# Autodesk Inventor assembly: ASSEMBLY_DUT_Ant_Rotator_REVC
(part 2 of 3)
304. DIN 912 - replaced by DIN EN ISO 4762 M4 x 10:2
305. DIN 125-1 A A 4,3:9
306. ISO 7380-1 M3 x 12:7
307. ISO 7380-1 M3 x 12:8
308. COTS_Fleximo_FB1ZP20C_20x20_End_Cap:5
309. COTS_Fleximo_FB1NM3_M3_Nut_20x20:5
310. COTS_Fleximo_FB1NM3_M3_Nut_20x20:6
311. COTS_Fleximo_FB1NM3_M3_Nut_20x20:7
312. COTS_Fleximo_FB1NM3_M3_Nut_20x20:8
313. COTS_Fleximo_FB1NM4_M4_Nut_20x20:4
314. COTS_Fleximo_FB1NM4_M4_Nut_20x20:5
315. COTS_Fleximo_FB1NM4_M4_Nut_20x20:6
316. COTS_Fleximo_FB1ZP20C_20x20_End_Cap:8
317. COTS_Fleximo_FB12020_20x20_Alu_Profile_575mm:3
318. 3DP_PLA_Foldable_Leg_Brace_Mount_REVB:5
319. COTS_GENERIC_5mm_Carbon_Rod:3
320. COTS_Fleximo_FB12020_20x20_Alu_Profile_600mm:3 — Flush:51, Flush:53
321. COTS_Fleximo_FBP2020_20x20_Hinge:3
322. COTS_Fleximo_FB1K2020_Angle:5
323. COTS_Fleximo_FB12020_20x20_Alu_Profile_150mm:5 — Mate:880, Flush:50
324. DIN 125-1 A A 4,3:10
325. DIN 912 - replaced by DIN EN ISO 4762 M4 x 16:5
326. DIN 912 - replaced by DIN EN ISO 4762 M4 x 16:6
327. DIN 125-1 A A 4,3:11
328. COTS_Fleximo_FB1K2020_Angle:6
329. 3DP_PLA_Foldable_Leg_Brace_Mount_REVB:6
330. ISO 7380-1 M3 x 12:9
331. ISO 7380-1 M3 x 12:10
332. COTS_Fleximo_FB12020_20x20_Alu_Profile_150mm:6 — Mate:881, Flush:52
333. DIN 912 - replaced by DIN EN ISO 4762 M4 x 10:3
334. DIN 125-1 A A 4,3:12
335. ISO 7380-1 M3 x 12:11
336. ISO 7380-1 M3 x 12:12
337. COTS_Fleximo_FB1ZP20C_20x20_End_Cap:7
338. COTS_Fleximo_FB1NM3_M3_Nut_20x20:9
339. COTS_Fleximo_FB1NM3_M3_Nut_20x20:10
340. COTS_Fleximo_FB1NM3_M3_Nut_20x20:11
341. COTS_Fleximo_FB1NM3_M3_Nut_20x20:12
342. COTS_Fleximo_FB1NM4_M4_Nut_20x20:7
343. COTS_Fleximo_FB1NM4_M4_Nut_20x20:8
344. COTS_Fleximo_FB1NM4_M4_Nut_20x20:9
345. COTS_Fleximo_FB1ZP20C_20x20_End_Cap:9
346. 3DP_PLA_Alu_Frame_Brace_REVB:1 — Mate:855, Flush:46, Mate:856, Mate:860, Mate:865, Mate:866, Mate:867, Mate:868, Mate:874, Mate:876
347. 3DP_PLA_Alu_Frame_Brace_REVB:2 — Mate:857, Flush:47, Mate:858, Mate:859, Angle:74, Mate:861, Mate:862, Mate:863, Mate:864
348. LC_3mm_ALU_Alu_Frame_Brace_REVB:1 — Mate:859, Mate:860, Angle:74, Mate:869, Mate:870, Mate:871, Mate:872, Mate:873, Mate:875
349. DIN 125-1 A A 4,3:21 — Mate:861, Mate:862, Insert:44
350. DIN 912 - replaced by DIN EN ISO 4762 M4 x 10:8 — Insert:44
351. DIN 125-1 A A 4,3:22 — Mate:863, Mate:864, Insert:45
352. DIN 912 - replaced by DIN EN ISO 4762 M4 x 10:9 — Insert:45
353. DIN 125-1 A A 4,3:23 — Mate:865, Mate:866, Insert:46
354. DIN 912 - replaced by DIN EN ISO 4762 M4 x 10:10 — Insert:46
355. DIN 125-1 A A 4,3:24 — Mate:867, Mate:868, Insert:47
356. DIN 912 - replaced by DIN EN ISO 4762 M4 x 10:11 — Insert:47
357. DIN 125-1 A A 4,3:25 — Mate:869, Mate:870, Insert:48
358. DIN 912 - replaced by DIN EN ISO 4762 M4 x 25:1 — Insert:48
359. DIN 934 - replaced by DIN EN 24032/28673/28674 M4:33 — Mate:873, Mate:874
360. DIN 125-1 A A 4,3:26 — Mate:871, Mate:872, Insert:49
361. DIN 912 - replaced by DIN EN ISO 4762 M4 x 25:2 — Insert:49
362. DIN 934 - replaced by DIN EN 24032/28673/28674 M4:34 — Mate:875, Mate:876
363. 3DP_PLA_Alu_Frame_Brace_REVB:3
364. 3DP_PLA_Alu_Frame_Brace_REVB:4
365. LC_3mm_ALU_Alu_Frame_Brace_REVB:2
366. DIN 125-1 A A 4,3:27
367. DIN 912 - replaced by DIN EN ISO 4762 M4 x 10:12
368. DIN 125-1 A A 4,3:28
369. DIN 912 - replaced by DIN EN ISO 4762 M4 x 10:13
370. DIN 125-1 A A 4,3:29
371. DIN 912 - replaced by DIN EN ISO 4762 M4 x 10:14
372. DIN 125-1 A A 4,3:30
373. DIN 912 - replaced by DIN EN ISO 4762 M4 x 10:15
374. DIN 125-1 A A 4,3:31
375. DIN 912 - replaced by DIN EN ISO 4762 M4 x 25:3
376. DIN 934 - replaced by DIN EN 24032/28673/28674 M4:35
377. DIN 125-1 A A 4,3:32
378. DIN 912 - replaced by DIN EN ISO 4762 M4 x 25:4
379. DIN 934 - replaced by DIN EN 24032/28673/28674 M4:36
380. 3DP_PLA_Alu_Frame_Brace_REVB:5
381. 3DP_PLA_Alu_Frame_Brace_REVB:6
382. LC_3mm_ALU_Alu_Frame_Brace_REVB:3
383. DIN 125-1 A A 4,3:33
384. DIN 912 - replaced by DIN EN ISO 4762 M4 x 10:16
385. DIN 125-1 A A 4,3:34
386. DIN 912 - replaced by DIN EN ISO 4762 M4 x 10:17
387. DIN 125-1 A A 4,3:35
388. DIN 912 - replaced by DIN EN ISO 4762 M4 x 10:18
389. DIN 125-1 A A 4,3:36
390. DIN 912 - replaced by DIN EN ISO 4762 M4 x 10:19
391. DIN 125-1 A A 4,3:37
392. DIN 912 - replaced by DIN EN ISO 4762 M4 x 25:5
393. DIN 934 - replaced by DIN EN 24032/28673/28674 M4:37
394. DIN 125-1 A A 4,3:38
395. DIN 912 - replaced by DIN EN ISO 4762 M4 x 25:6
396. DIN 934 - replaced by DIN EN 24032/28673/28674 M4:38
397. 3DP_PLA_Folded_Leg_Holder_REVB:1 — Mate:877, Flush:48, Flush:49, Mate:878, Mate:879
398. DIN 912 - replaced by DIN EN ISO 4762 M4 x 16:7 — Mate:878, Mate:879
399. 3DP_PLA_Folded_Leg_Holder_REVB:2
400. DIN 912 - replaced by DIN EN ISO 4762 M4 x 16:8
401. 3DP_PLA_Folded_Leg_Holder_REVB:3 — Flush:60
402. DIN 912 - replaced by DIN EN ISO 4762 M4 x 16:9
403. ISO 7380-1 M6 x 16:1 — Mate:891, Mate:892
404. 3DP_PLA_Frame_Stiffener_and_Leg_REVB:1 — Mate:890, Flush:54, Flush:55, Mate:891, Mate:892, Mate:893, Mate:894, Mate:895, Mate:896
405. ISO 7380-1 M5 x 8:1 — Mate:893, Mate:894
406. ISO 7380-1 M5 x 8:2 — Mate:895, Mate:896
407. 3DP_PLA_Frame_Stiffener_and_Leg_REVB:2 — Mate:897, Flush:56, Flush:57, Mate:898, Mate:899, Mate:900, Mate:901, Mate:902, Mate:903
408. ISO 7380-1 M6 x 16:2 — Mate:898, Mate:899
409. ISO 7380-1 M5 x 8:3 — Mate:900, Mate:901
410. ISO 7380-1 M5 x 8:4 — Mate:902, Mate:903
411. ISO 7380-1 M6 x 16:3
412. 3DP_PLA_Frame_Stiffener_and_Leg_REVB:3
413. ISO 7380-1 M5 x 8:5
414. ISO 7380-1 M5 x 8:6
415. 3DP_PLA_Frame_Stiffener_and_Leg_REVB:4
416. ISO 7380-1 M6 x 16:4
417. ISO 7380-1 M5 x 8:7
418. ISO 7380-1 M5 x 8:8
419. ISO 7380-1 M6 x 16:5
420. 3DP_PLA_Frame_Stiffener_and_Leg_REVB:5
421. ISO 7380-1 M5 x 8:9
422. ISO 7380-1 M5 x 8:10
423. 3DP_PLA_Frame_Stiffener_and_Leg_REVB:6
424. ISO 7380-1 M6 x 16:6
425. ISO 7380-1 M5 x 8:11
426. ISO 7380-1 M5 x 8:12
427. ISO 7380-1 M5 x 8:13 — Mate:905, Mate:906
428. 3DP_PLA_Frame_Leg_Leg_REVB:1 — Mate:904, Flush:58, Flush:59, Mate:905, Mate:906, Mate:907, Mate:908
429. ISO 7380-1 M5 x 8:14 — Mate:907, Mate:908
430. ISO 7380-1 M5 x 8:15
431. 3DP_PLA_Frame_Leg_Leg_REVB:2
432. ISO 7380-1 M5 x 8:16
433. ISO 7380-1 M5 x 8:17
434. 3DP_PLA_Frame_Leg_Leg_REVB:3
435. ISO 7380-1 M5 x 8:18
## Component patterns: (3 elements, first: COTS_Fleximo_FB12020_20x20_Alu_Profile_575mm:1 + 3DP_PLA_Foldable_Leg_Brace_Mount_REVB:1 + COTS_GENERIC_5mm_Carbon_Rod:1 + COTS_Fleximo_FB12020_20x20_Alu_Profile_600mm:1 + COTS_Fleximo_FBP2020_20x20_Hinge:1 + COTS_Fleximo_FB1K2020_Angle:1 + COTS_Fleximo_FB12020_20x20_Alu_Profile_150mm:2 + DIN 125-1 A A 4,3:5 + DIN 912 - replaced by DIN EN ISO 4762 M4 x 16:1 + DIN 912 - replaced by DIN EN ISO 4762 M4 x 16:2 + DIN 125-1 A A 4,3:6 + COTS_Fleximo_FB1K2020_Angle:2 + 3DP_PLA_Foldable_Leg_Brace_Mount_REVB:2 + ISO 7380-1 M3 x 12:4 + ISO 7380-1 M3 x 12:3 + COTS_Fleximo_FB12020_20x20_Alu_Profile_150mm:1 + DIN 912 - replaced by DIN EN ISO 4762 M4 x 10:1 + DIN 125-1 A A 4,3:4 + ISO 7380-1 M3 x 12:1 + ISO 7380-1 M3 x 12:2 + COTS_Fleximo_FB1ZP20C_20x20_End_Cap:3 + COTS_Fleximo_FB1NM3_M3_Nut_20x20:4 + COTS_Fleximo_FB1NM3_M3_Nut_20x20:3 + COTS_Fleximo_FB1NM3_M3_Nut_20x20:2 + COTS_Fleximo_FB1NM3_M3_Nut_20x20:1 + COTS_Fleximo_FB1NM4_M4_Nut_20x20:1 + COTS_Fleximo_FB1NM4_M4_Nut_20x20:3 + COTS_Fleximo_FB1NM4_M4_Nut_20x20:2 + COTS_Fleximo_FB1ZP20C_20x20_End_Cap:2), (3 elements, first: 3DP_PLA_Alu_Frame_Brace_REVB:1 + 3DP_PLA_Alu_Frame_Brace_REVB:2 + LC_3mm_ALU_Alu_Frame_Brace_REVB:1 + DIN 125-1 A A 4,3:21 + DIN 912 - replaced by DIN EN ISO 4762 M4 x 10:8 + DIN 125-1 A A 4,3:22 + DIN 912 - replaced by DIN EN ISO 4762 M4 x 10:9 + DIN 125-1 A A 4,3:23 + DIN 912 - replaced by DIN EN ISO 4762 M4 x 10:10 + DIN 125-1 A A 4,3:24 + DIN 912 - replaced by DIN EN ISO 4762 M4 x 10:11 + DIN 125-1 A A 4,3:25 + DIN 912 - replaced by DIN EN ISO 4762 M4 x 25:1 + DIN 934 - replaced by DIN EN 24032/28673/28674 M4:33 + DIN 125-1 A A 4,3:26 + DIN 912 - replaced by DIN EN ISO 4762 M4 x 25:2 + DIN 934 - replaced by DIN EN 24032/28673/28674 M4:34), (3 elements, first: 3DP_PLA_Folded_Leg_Holder_REVB:1 + DIN 912 - replaced by DIN EN ISO 4762 M4 x 16:7), (3 elements, first: ISO 7380-1 M6 x 16:1 + 3DP_PLA_Frame_Stiffener_and_Leg_REVB:1 + ISO 7380-1 M5 x 8:1 + ISO 7380-1 M5 x 8:2 + 3DP_PLA_Frame_Stiffener_and_Leg_REVB:2 + ISO 7380-1 M6 x 16:2 + ISO 7380-1 M5 x 8:3 + ISO 7380-1 M5 x 8:4), (3 elements, first: ISO 7380-1 M5 x 8:13 + 3DP_PLA_Frame_Leg_Leg_REVB:1 + ISO 7380-1 M5 x 8:14)
## Relationships (687: Mate 547, Angle 50, Flush 49, Insert 41)
- Mate:1: 3DP_PLA_A_Axis_Bearing_Base:1
- Mate:2: 3DP_PLA_A_Axis_Bearing_Base:1
- Mate:3: COTS_GENERIC_6020_2RS_150x100x24mm_Ball_Bearing:1 ↔ 3DP_PLA_A_Axis_Bearing_Base:1
- Mate:4: COTS_GENERIC_6020_2RS_150x100x24mm_Ball_Bearing:1 ↔ 3DP_PLA_A_Axis_Bearing_Base:1
- Mate:5 (0.2 mm): 3DP_PLA_A_Axis_Bearing_Base:1 ↔ 3DP_PLA_A_Axis_Bearing_Base_Bearing_Locking_Ring:1
- Mate:6: 3DP_PLA_A_Axis_Bearing_Base:1 ↔ 3DP_PLA_A_Axis_Bearing_Base_Bearing_Locking_Ring:1
- Mate:7: 3DP_PLA_A_Axis_Bearing_Base:1 ↔ 3DP_PLA_A_Axis_Bearing_Base_Bearing_Locking_Ring:1
- Mate:8: 3DP_PLA_A_Axis_Bearing_Base_Bearing_Locking_Ring:1 ↔ ISO 7380-1 M4 x 40:1
- Mate:9: 3DP_PLA_A_Axis_Bearing_Base_Bearing_Locking_Ring:1 ↔ ISO 7380-1 M4 x 40:1
- Mate:10: 3DP_PLA_A_Axis_Bearing_Base_Bearing_Locking_Ring:1 ↔ ISO 7380-1 M4 x 40:2
- Mate:11: 3DP_PLA_A_Axis_Bearing_Base_Bearing_Locking_Ring:1 ↔ ISO 7380-1 M4 x 40:2
- Mate:12: 3DP_PLA_A_Axis_Bearing_Base_Bearing_Locking_Ring:1 ↔ ISO 7380-1 M4 x 40:3
- Mate:13: 3DP_PLA_A_Axis_Bearing_Base_Bearing_Locking_Ring:1 ↔ ISO 7380-1 M4 x 40:3
- Mate:14: 3DP_PLA_A_Axis_Bearing_Base_Bearing_Locking_Ring:1 ↔ ISO 7380-1 M4 x 40:4
- Mate:15: 3DP_PLA_A_Axis_Bearing_Base_Bearing_Locking_Ring:1 ↔ ISO 7380-1 M4 x 40:4
- Mate:16: 3DP_PLA_A_Axis_Bearing_Base_Bearing_Locking_Ring:1 ↔ ISO 7380-1 M4 x 40:5
- Mate:17: 3DP_PLA_A_Axis_Bearing_Base_Bearing_Locking_Ring:1 ↔ ISO 7380-1 M4 x 40:5
- Mate:18: 3DP_PLA_A_Axis_Bearing_Base_Bearing_Locking_Ring:1 ↔ ISO 7380-1 M4 x 40:6
- Mate:19: 3DP_PLA_A_Axis_Bearing_Base_Bearing_Locking_Ring:1 ↔ ISO 7380-1 M4 x 40:6
- Mate:20: 3DP_PLA_A_Axis_Bearing_Base_Bearing_Locking_Ring:1 ↔ ISO 7380-1 M4 x 40:7
- Mate:21: 3DP_PLA_A_Axis_Bearing_Base_Bearing_Locking_Ring:1 ↔ ISO 7380-1 M4 x 40:7
- Mate:22: 3DP_PLA_A_Axis_Bearing_Base_Bearing_Locking_Ring:1 ↔ ISO 7380-1 M4 x 40:8
- Mate:23: 3DP_PLA_A_Axis_Bearing_Base_Bearing_Locking_Ring:1 ↔ ISO 7380-1 M4 x 40:8
- Mate:24: 3DP_PLA_A_Axis_Bearing_Base_Bearing_Locking_Ring:1 ↔ DIN 934 - replaced by DIN EN 24032/28673/28674 M4:1
- Mate:25: 3DP_PLA_A_Axis_Bearing_Base:1 ↔ DIN 934 - replaced by DIN EN 24032/28673/28674 M4:1
- Mate:26: 3DP_PLA_A_Axis_Bearing_Base_Bearing_Locking_Ring:1 ↔ DIN 934 - replaced by DIN EN 24032/28673/28674 M4:2
- Mate:27: 3DP_PLA_A_Axis_Bearing_Base:1 ↔ DIN 934 - replaced by DIN EN 24032/28673/28674 M4:2
- Mate:28: 3DP_PLA_A_Axis_Bearing_Base_Bearing_Locking_Ring:1 ↔ DIN 934 - replaced by DIN EN 24032/28673/28674 M4:3
- Mate:29: 3DP_PLA_A_Axis_Bearing_Base:1 ↔ DIN 934 - replaced by DIN EN 24032/28673/28674 M4:3
- Mate:30: 3DP_PLA_A_Axis_Bearing_Base_Bearing_Locking_Ring:1 ↔ DIN 934 - replaced by DIN EN 24032/28673/28674 M4:4
- Mate:31: 3DP_PLA_A_Axis_Bearing_Base:1 ↔ DIN 934 - replaced by DIN EN 24032/28673/28674 M4:4
- Mate:32: 3DP_PLA_A_Axis_Bearing_Base_Bearing_Locking_Ring:1 ↔ DIN 934 - replaced by DIN EN 24032/28673/28674 M4:5
- Mate:33: 3DP_PLA_A_Axis_Bearing_Base:1 ↔ DIN 934 - replaced by DIN EN 24032/28673/28674 M4:5
- Mate:34: 3DP_PLA_A_Axis_Bearing_Base_Bearing_Locking_Ring:1 ↔ DIN 934 - replaced by DIN EN 24032/28673/28674 M4:6
- Mate:35: 3DP_PLA_A_Axis_Bearing_Base:1 ↔ DIN 934 - replaced by DIN EN 24032/28673/28674 M4:6
- Mate:36: 3DP_PLA_A_Axis_Bearing_Base_Bearing_Locking_Ring:1 ↔ DIN 934 - replaced by DIN EN 24032/28673/28674 M4:7
- Mate:37: 3DP_PLA_A_Axis_Bearing_Base:1 ↔ DIN 934 - replaced by DIN EN 24032/28673/28674 M4:7
- Mate:38: 3DP_PLA_A_Axis_Bearing_Base_Bearing_Locking_Ring:1 ↔ DIN 934 - replaced by DIN EN 24032/28673/28674 M4:8
- Mate:39: 3DP_PLA_A_Axis_Bearing_Base:1 ↔ DIN 934 - replaced by DIN EN 24032/28673/28674 M4:8
- Angle:1 (0 deg): 3DP_PLA_A_Axis_Bearing_Base:1 ↔ DIN 934 - replaced by DIN EN 24032/28673/28674 M4:2
- Angle:2 (0 deg): 3DP_PLA_A_Axis_Bearing_Base:1 ↔ DIN 934 - replaced by DIN EN 24032/28673/28674 M4:3
- Angle:3 (0 deg): 3DP_PLA_A_Axis_Bearing_Base:1 ↔ DIN 934 - replaced by DIN EN 24032/28673/28674 M4:4
- Angle:4 (0 deg): 3DP_PLA_A_Axis_Bearing_Base:1 ↔ DIN 934 - replaced by DIN EN 24032/28673/28674 M4:5
- Angle:5 (0 deg): 3DP_PLA_A_Axis_Bearing_Base:1 ↔ DIN 934 - replaced by DIN EN 24032/28673/28674 M4:6
- Angle:6 (0 deg): 3DP_PLA_A_Axis_Bearing_Base:1 ↔ DIN 934 - replaced by DIN EN 24032/28673/28674 M4:7
- Angle:7 (0 deg): 3DP_PLA_A_Axis_Bearing_Base:1 ↔ DIN 934 - replaced by DIN EN 24032/28673/28674 M4:8
- Angle:8 (0 deg): 3DP_PLA_A_Axis_Bearing_Base:1 ↔ DIN 934 - replaced by DIN EN 24032/28673/28674 M4:1
- Mate:40: COTS_GENERIC_6020_2RS_150x100x24mm_Ball_Bearing:1 ↔ 3DP_PLA_A_Axis_Rotating_Stage:1
- Mate:41: COTS_GENERIC_6020_2RS_150x100x24mm_Ball_Bearing:1 ↔ 3DP_PLA_A_Axis_Rotating_Stage:1
- Mate:42: COTS_GENERIC_6020_2RS_150x100x24mm_Ball_Bearing:1 ↔ 3DP_PLA_A_Axis_Rotating_Stage_Mounting_Plate:1
- Mate:43: COTS_GENERIC_6020_2RS_150x100x24mm_Ball_Bearing:1 ↔ 3DP_PLA_A_Axis_Rotating_Stage_Mounting_Plate:1
- Mate:44: 3DP_PLA_A_Axis_Rotating_Stage:1 ↔ 3DP_PLA_A_Axis_Rotating_Stage_Mounting_Plate:1
- Mate:45: 3DP_PLA_A_Axis_Rotating_Stage:1 ↔ DIN 912 - replaced by DIN EN ISO 4762 M5 x 50:1
- Mate:46: 3DP_PLA_A_Axis_Rotating_Stage:1 ↔ DIN 912 - replaced by DIN EN ISO 4762 M5 x 50:1
- Mate:47: 3DP_PLA_A_Axis_Rotating_Stage:1 ↔ DIN 912 - replaced by DIN EN ISO 4762 M5 x 50:2
- Mate:48: 3DP_PLA_A_Axis_Rotating_Stage:1 ↔ DIN 912 - replaced by DIN EN ISO 4762 M5 x 50:2
- Mate:49: 3DP_PLA_A_Axis_Rotating_Stage:1 ↔ DIN 912 - replaced by DIN EN ISO 4762 M5 x 50:3
- Mate:50: 3DP_PLA_A_Axis_Rotating_Stage:1 ↔ DIN 912 - replaced by DIN EN ISO 4762 M5 x 50:3
- Mate:51: 3DP_PLA_A_Axis_Rotating_Stage:1 ↔ DIN 912 - replaced by DIN EN ISO 4762 M5 x 50:4
- Mate:52: 3DP_PLA_A_Axis_Rotating_Stage:1 ↔ DIN 912 - replaced by DIN EN ISO 4762 M5 x 50:4
- Mate:53: 3DP_PLA_A_Axis_Rotating_Stage:1 ↔ DIN 912 - replaced by DIN EN ISO 4762 M5 x 50:5
- Mate:54: 3DP_PLA_A_Axis_Rotating_Stage:1 ↔ DIN 912 - replaced by DIN EN ISO 4762 M5 x 50:5
- Mate:55: 3DP_PLA_A_Axis_Rotating_Stage:1 ↔ DIN 912 - replaced by DIN EN ISO 4762 M5 x 50:6
- Mate:56: 3DP_PLA_A_Axis_Rotating_Stage:1 ↔ DIN 912 - replaced by DIN EN ISO 4762 M5 x 50:6
- Mate:57: 3DP_PLA_A_Axis_Rotating_Stage:1 ↔ DIN 912 - replaced by DIN EN ISO 4762 M5 x 50:7
- Mate:58: 3DP_PLA_A_Axis_Rotating_Stage:1 ↔ DIN 912 - replaced by DIN EN ISO 4762 M5 x 50:7
- Mate:59: 3DP_PLA_A_Axis_Rotating_Stage:1 ↔ DIN 912 - replaced by DIN EN ISO 4762 M5 x 50:8
- Mate:60: 3DP_PLA_A_Axis_Rotating_Stage:1 ↔ DIN 912 - replaced by DIN EN ISO 4762 M5 x 50:8
- Mate:61: 3DP_PLA_A_Axis_Rotating_Stage:1 ↔ DIN 934 - replaced by DIN EN 24032/28673/28674 M5:1
- Mate:62: 3DP_PLA_A_Axis_Rotating_Stage_Mounting_Plate:1 ↔ DIN 934 - replaced by DIN EN 24032/28673/28674 M5:1
- Mate:63: 3DP_PLA_A_Axis_Rotating_Stage:1 ↔ DIN 934 - replaced by DIN EN 24032/28673/28674 M5:2
- Mate:64: 3DP_PLA_A_Axis_Rotating_Stage_Mounting_Plate:1 ↔ DIN 934 - replaced by DIN EN 24032/28673/28674 M5:2
- Mate:65: 3DP_PLA_A_Axis_Rotating_Stage:1 ↔ DIN 934 - replaced by DIN EN 24032/28673/28674 M5:3
- Mate:66: 3DP_PLA_A_Axis_Rotating_Stage_Mounting_Plate:1 ↔ DIN 934 - replaced by DIN EN 24032/28673/28674 M5:3
- Mate:67: 3DP_PLA_A_Axis_Rotating_Stage:1 ↔ DIN 934 - replaced by DIN EN 24032/28673/28674 M5:4
- Mate:68: 3DP_PLA_A_Axis_Rotating_Stage_Mounting_Plate:1 ↔ DIN 934 - replaced by DIN EN 24032/28673/28674 M5:4
- Mate:69: 3DP_PLA_A_Axis_Rotating_Stage:1 ↔ DIN 934 - replaced by DIN EN 24032/28673/28674 M5:5
- Mate:70: 3DP_PLA_A_Axis_Rotating_Stage_Mounting_Plate:1 ↔ DIN 934 - replaced by DIN EN 24032/28673/28674 M5:5
- Mate:71: 3DP_PLA_A_Axis_Rotating_Stage:1 ↔ DIN 934 - replaced by DIN EN 24032/28673/28674 M5:6
- Mate:72: 3DP_PLA_A_Axis_Rotating_Stage_Mounting_Plate:1 ↔ DIN 934 - replaced by DIN EN 24032/28673/28674 M5:6
- Mate:73: 3DP_PLA_A_Axis_Rotating_Stage:1 ↔ DIN 934 - replaced by DIN EN 24032/28673/28674 M5:7
- Mate:74: 3DP_PLA_A_Axis_Rotating_Stage_Mounting_Plate:1 ↔ DIN 934 - replaced by DIN EN 24032/28673/28674 M5:7
- Mate:75: 3DP_PLA_A_Axis_Rotating_Stage:1 ↔ DIN 934 - replaced by DIN EN 24032/28673/28674 M5:8
- Mate:76: 3DP_PLA_A_Axis_Rotating_Stage_Mounting_Plate:1 ↔ DIN 934 - replaced by DIN EN 24032/28673/28674 M5:8
- Angle:9 (0 deg): 3DP_PLA_A_Axis_Rotating_Stage_Mounting_Plate:1 ↔ DIN 934 - replaced by DIN EN 24032/28673/28674 M5:2
- Angle:10 (0 deg): 3DP_PLA_A_Axis_Rotating_Stage_Mounting_Plate:1 ↔ DIN 934 - replaced by DIN EN 24032/28673/28674 M5:3
- Angle:11 (0 deg): 3DP_PLA_A_Axis_Rotating_Stage_Mounting_Plate:1 ↔ DIN 934 - replaced by DIN EN 24032/28673/28674 M5:4
- Angle:12 (0 deg): 3DP_PLA_A_Axis_Rotating_Stage_Mounting_Plate:1 ↔ DIN 934 - replaced by DIN EN 24032/28673/28674 M5:5
- Angle:13 (0 deg): 3DP_PLA_A_Axis_Rotating_Stage_Mounting_Plate:1 ↔ DIN 934 - replaced by DIN EN 24032/28673/28674 M5:6
- Angle:14 (0 deg): 3DP_PLA_A_Axis_Rotating_Stage_Mounting_Plate:1 ↔ DIN 934 - replaced by DIN EN 24032/28673/28674 M5:7
- Angle:15 (0 deg): 3DP_PLA_A_Axis_Rotating_Stage_Mounting_Plate:1 ↔ DIN 934 - replaced by DIN EN 24032/28673/28674 M5:8
- Angle:16 (0 deg): 3DP_PLA_A_Axis_Rotating_Stage_Mounting_Plate:1 ↔ DIN 934 - replaced by DIN EN 24032/28673/28674 M5:1
- Mate:77: COTS_MKS_SERVO42D_40mm:1 ↔ COTS_GENERIC_HTD3M_24T_6mm_5mm_shaft_pulley:1
- Mate:78: 3DP_PLA_A_Axis_Rotating_Stage:1 ↔ COTS_GENERIC_HTD3M_6mm_675mm_Closed_belt_A_Axis:1
- Mate:79 (0.5 mm): 3DP_PLA_A_Axis_Rotating_Stage:1 ↔ COTS_GENERIC_HTD3M_6mm_675mm_Closed_belt_A_Axis:1
- Angle:17 (0 deg): 3DP_PLA_A_Axis_Bearing_Base:1
- Mate:80: 3DP_PLA_A_Axis_Bearing_Base:1 ↔ 3DP_PLA_A_Axis_Stepper_Mount_REVB:1
- Mate:81: 3DP_PLA_A_Axis_Bearing_Base:1 ↔ 3DP_PLA_A_Axis_Stepper_Mount_REVB:1
- Mate:82: 3DP_PLA_A_Axis_Bearing_Base:1 ↔ 3DP_PLA_A_Axis_Stepper_Mount_REVB:1
- Mate:83: 3DP_PLA_A_Axis_Stepper_Mount_REVB:1 ↔ ISO 7380-1 M4 x 40:9
- Mate:84: 3DP_PLA_A_Axis_Stepper_Mount_REVB:1 ↔ ISO 7380-1 M4 x 40:9
- Mate:85: 3DP_PLA_A_Axis_Stepper_Mount_REVB:1 ↔ ISO 7380-1 M4 x 40:10
- Mate:86: 3DP_PLA_A_Axis_Stepper_Mount_REVB:1 ↔ ISO 7380-1 M4 x 40:10
- Mate:87: 3DP_PLA_A_Axis_Stepper_Mount_REVB:1 ↔ ISO 7380-1 M4 x 40:11
- Mate:88: 3DP_PLA_A_Axis_Stepper_Mount_REVB:1 ↔ ISO 7380-1 M4 x 40:11
- Mate:89: 3DP_PLA_A_Axis_Stepper_Mount_REVB:1 ↔ DIN 934 - replaced by DIN EN 24032/28673/28674 M4:9
- Mate:90: 3DP_PLA_A_Axis_Bearing_Base:1 ↔ DIN 934 - replaced by DIN EN 24032/28673/28674 M4:9
- Mate:91: 3DP_PLA_A_Axis_Stepper_Mount_REVB:1 ↔ DIN 934 - replaced by DIN EN 24032/28673/28674 M4:10
- Mate:92: 3DP_PLA_A_Axis_Bearing_Base:1 ↔ DIN 934 - replaced by DIN EN 24032/28673/28674 M4:10
- Mate:93: 3DP_PLA_A_Axis_Stepper_Mount_REVB:1 ↔ DIN 934 - replaced by DIN EN 24032/28673/28674 M4:11
- Mate:94: 3DP_PLA_A_Axis_Bearing_Base:1 ↔ DIN 934 - replaced by DIN EN 24032/28673/28674 M4:11
- Angle:18 (0 deg): 3DP_PLA_A_Axis_Bearing_Base:1 ↔ DIN 934 - replaced by DIN EN 24032/28673/28674 M4:9
- Angle:19 (0 deg): 3DP_PLA_A_Axis_Bearing_Base:1 ↔ DIN 934 - replaced by DIN EN 24032/28673/28674 M4:10
- Angle:20 (0 deg): 3DP_PLA_A_Axis_Bearing_Base:1 ↔ DIN 934 - replaced by DIN EN 24032/28673/28674 M4:11
- Mate:95: 3DP_PLA_A_Axis_Stepper_Mount_REVB:1 ↔ ASSEMBLY_HTD3M_Idler_A_Axis:2
- Mate:96: 3DP_PLA_A_Axis_Stepper_Mount_REVB:1 ↔ ASSEMBLY_HTD3M_Idler_A_Axis:1
- Mate:97: 3DP_PLA_A_Axis_Stepper_Mount_REVB:1 ↔ ASSEMBLY_HTD3M_Idler_A_Axis:2
- Mate:98: 3DP_PLA_A_Axis_Stepper_Mount_REVB:1 ↔ ASSEMBLY_HTD3M_Idler_A_Axis:1
- Mate:107: COTS_MKS_SERVO42D_40mm:1 ↔ 3DP_PLA_A_Axis_Stepper_Mount_REVB:1
- Mate:108 (1.6 mm): COTS_MKS_SERVO42D_40mm:1 ↔ 3DP_PLA_A_Axis_Stepper_Mount_REVB:1
- Mate:109 (1.6 mm): COTS_MKS_SERVO42D_40mm:1 ↔ 3DP_PLA_A_Axis_Stepper_Mount_REVB:1
- Mate:110: COTS_MKS_SERVO42D_40mm:1 ↔ DIN 125-1 A A 3,2:1
- Mate:111: 3DP_PLA_A_Axis_Stepper_Mount_REVB:1 ↔ DIN 125-1 A A 3,2:1
- Mate:112: COTS_MKS_SERVO42D_40mm:1 ↔ DIN 125-1 A A 3,2:2
- Mate:113: 3DP_PLA_A_Axis_Stepper_Mount_REVB:1 ↔ DIN 125-1 A A 3,2:2
- Mate:114: COTS_MKS_SERVO42D_40mm:1 ↔ DIN 125-1 A A 3,2:3
- Mate:115: 3DP_PLA_A_Axis_Stepper_Mount_REVB:1 ↔ DIN 125-1 A A 3,2:3
- Mate:116: COTS_MKS_SERVO42D_40mm:1 ↔ DIN 125-1 A A 3,2:4
- Mate:117: 3DP_PLA_A_Axis_Stepper_Mount_REVB:1 ↔ DIN 125-1 A A 3,2:4
- Insert:1: ISO 7380-1 M3 x 16:1 ↔ DIN 125-1 A A 3,2:1
- Insert:2: ISO 7380-1 M3 x 16:2 ↔ DIN 125-1 A A 3,2:2
- Insert:3: ISO 7380-1 M3 x 16:3 ↔ DIN 125-1 A A 3,2:3
- Insert:4: ISO 7380-1 M3 x 16:4 ↔ DIN 125-1 A A 3,2:4
- Mate:118: COTS_GENERIC_HTD3M_24T_6mm_5mm_shaft_pulley:1 ↔ COTS_GENERIC_HTD3M_6mm_675mm_Closed_belt_A_Axis:1
- Mate:119 (0.5 mm): COTS_GENERIC_HTD3M_24T_6mm_5mm_shaft_pulley:1 ↔ COTS_GENERIC_HTD3M_6mm_675mm_Closed_belt_A_Axis:1
- Mate:121: 3DP_PLA_A_Axis_Rotating_Stage:1 ↔ 3DP_PLA_A_Axis_Rotating_Stage_Fiberglass_pipes_mount_plate:1
- Mate:122: 3DP_PLA_A_Axis_Rotating_Stage:1 ↔ 3DP_PLA_A_Axis_Rotating_Stage_Fiberglass_pipes_mount_plate:1
- Mate:123: 3DP_PLA_A_Axis_Rotating_Stage:1 ↔ 3DP_PLA_A_Axis_Rotating_Stage_Fiberglass_pipes_mount_plate:1
- Mate:127 (1 mm): 3DP_PLA_A_Axis_Rotating_Stage_Fiberglass_pipes_mount_plate:1 ↔ 3DP_PLA_A_Axis_Rotating_Stage_Fiberglass_pipes_mount_clamp:2
- Mate:128 (1 mm): 3DP_PLA_A_Axis_Rotating_Stage_Fiberglass_pipes_mount_plate:1 ↔ 3DP_PLA_A_Axis_Rotating_Stage_Fiberglass_pipes_mount_clamp:1
- Flush:3: 3DP_PLA_A_Axis_Rotating_Stage_Fiberglass_pipes_mount_plate:1 ↔ 3DP_PLA_A_Axis_Rotating_Stage_Fiberglass_pipes_mount_clamp:2
- Flush:4: 3DP_PLA_A_Axis_Rotating_Stage_Fiberglass_pipes_mount_plate:1 ↔ 3DP_PLA_A_Axis_Rotating_Stage_Fiberglass_pipes_mount_clamp:2
- Flush:5: 3DP_PLA_A_Axis_Rotating_Stage_Fiberglass_pipes_mount_plate:1 ↔ 3DP_PLA_A_Axis_Rotating_Stage_Fiberglass_pipes_mount_clamp:1
- Flush:6: 3DP_PLA_A_Axis_Rotating_Stage_Fiberglass_pipes_mount_plate:1 ↔ 3DP_PLA_A_Axis_Rotating_Stage_Fiberglass_pipes_mount_clamp:1
- Mate:129: 3DP_PLA_A_Axis_Rotating_Stage_Fiberglass_pipes_mount_clamp:2 ↔ DIN 912 - replaced by DIN EN ISO 4762 M5 x 50:9
- Mate:130: 3DP_PLA_A_Axis_Rotating_Stage_Fiberglass_pipes_mount_clamp:2 ↔ DIN 912 - replaced by DIN EN ISO 4762 M5 x 50:9
- Mate:131: 3DP_PLA_A_Axis_Rotating_Stage_Fiberglass_pipes_mount_clamp:2 ↔ DIN 912 - replaced by DIN EN ISO 4762 M5 x 50:10
- Mate:132: 3DP_PLA_A_Axis_Rotating_Stage_Fiberglass_pipes_mount_clamp:2 ↔ DIN 912 - replaced by DIN EN ISO 4762 M5 x 50:10
- Mate:133: 3DP_PLA_A_Axis_Rotating_Stage_Fiberglass_pipes_mount_clamp:2 ↔ DIN 912 - replaced by DIN EN ISO 4762 M5 x 50:11
- Mate:134: 3DP_PLA_A_Axis_Rotating_Stage_Fiberglass_pipes_mount_clamp:2 ↔ DIN 912 - replaced by DIN EN ISO 4762 M5 x 50:11
- Mate:135: 3DP_PLA_A_Axis_Rotating_Stage_Fiberglass_pipes_mount_clamp:2 ↔ DIN 912 - replaced by DIN EN ISO 4762 M5 x 50:12
- Mate:136: 3DP_PLA_A_Axis_Rotating_Stage_Fiberglass_pipes_mount_clamp:2 ↔ DIN 912 - replaced by DIN EN ISO 4762 M5 x 50:12
- Mate:137: 3DP_PLA_A_Axis_Rotating_Stage_Fiberglass_pipes_mount_clamp:2 ↔ DIN 912 - replaced by DIN EN ISO 4762 M5 x 50:13
- Mate:138: 3DP_PLA_A_Axis_Rotating_Stage_Fiberglass_pipes_mount_clamp:2 ↔ DIN 912 - replaced by DIN EN ISO 4762 M5 x 50:13
- Mate:139: 3DP_PLA_A_Axis_Rotating_Stage_Fiberglass_pipes_mount_clamp:2 ↔ DIN 912 - replaced by DIN EN ISO 4762 M5 x 50:14
- Mate:140: 3DP_PLA_A_Axis_Rotating_Stage_Fiberglass_pipes_mount_clamp:2 ↔ DIN 912 - replaced by DIN EN ISO 4762 M5 x 50:14
- Mate:141: 3DP_PLA_A_Axis_Rotating_Stage_Fiberglass_pipes_mount_clamp:1 ↔ DIN 912 - replaced by DIN EN ISO 4762 M5 x 50:15
- Mate:142: 3DP_PLA_A_Axis_Rotating_Stage_Fiberglass_pipes_mount_clamp:2 ↔ DIN 912 - replaced by DIN EN ISO 4762 M5 x 50:15
- Mate:143: 3DP_PLA_A_Axis_Rotating_Stage_Fiberglass_pipes_mount_clamp:1 ↔ DIN 912 - replaced by DIN EN ISO 4762 M5 x 50:16
- Mate:144: 3DP_PLA_A_Axis_Rotating_Stage_Fiberglass_pipes_mount_clamp:2 ↔ DIN 912 - replaced by DIN EN ISO 4762 M5 x 50:16
- Mate:145: 3DP_PLA_A_Axis_Rotating_Stage_Fiberglass_pipes_mount_clamp:1 ↔ DIN 912 - replaced by DIN EN ISO 4762 M5 x 50:17
- Mate:146: 3DP_PLA_A_Axis_Rotating_Stage_Fiberglass_pipes_mount_clamp:2 ↔ DIN 912 - replaced by DIN EN ISO 4762 M5 x 50:17
- Mate:147: 3DP_PLA_A_Axis_Rotating_Stage_Fiberglass_pipes_mount_clamp:1 ↔ DIN 912 - replaced by DIN EN ISO 4762 M5 x 50:18
- Mate:148: 3DP_PLA_A_Axis_Rotating_Stage_Fiberglass_pipes_mount_clamp:2 ↔ DIN 912 - replaced by DIN EN ISO 4762 M5 x 50:18
- Mate:149: 3DP_PLA_A_Axis_Rotating_Stage_Fiberglass_pipes_mount_clamp:1 ↔ DIN 912 - replaced by DIN EN ISO 4762 M5 x 50:19
- Mate:150: 3DP_PLA_A_Axis_Rotating_Stage_Fiberglass_pipes_mount_clamp:2 ↔ DIN 912 - replaced by DIN EN ISO 4762 M5 x 50:19
- Mate:151: 3DP_PLA_A_Axis_Rotating_Stage_Fiberglass_pipes_mount_clamp:1 ↔ DIN 912 - replaced by DIN EN ISO 4762 M5 x 50:20
- Mate:152: 3DP_PLA_A_Axis_Rotating_Stage_Fiberglass_pipes_mount_clamp:2 ↔ DIN 912 - replaced by DIN EN ISO 4762 M5 x 50:20
- Mate:153: 3DP_PLA_A_Axis_Rotating_Stage_Fiberglass_pipes_mount_clamp:2 ↔ DIN 934 - replaced by DIN EN 24032/28673/28674 M5:9
- Mate:154: 3DP_PLA_A_Axis_Rotating_Stage_Fiberglass_pipes_mount_plate:1 ↔ DIN 934 - replaced by DIN EN 24032/28673/28674 M5:9
- Mate:155: 3DP_PLA_A_Axis_Rotating_Stage_Fiberglass_pipes_mount_clamp:2 ↔ DIN 934 - replaced by DIN EN 24032/28673/28674 M5:10
- Mate:156: 3DP_PLA_A_Axis_Rotating_Stage_Fiberglass_pipes_mount_plate:1 ↔ DIN 934 - replaced by DIN EN 24032/28673/28674 M5:10
- Mate:157: 3DP_PLA_A_Axis_Rotating_Stage_Fiberglass_pipes_mount_clamp:2 ↔ DIN 934 - replaced by DIN EN 24032/28673/28674 M5:11
- Mate:158: 3DP_PLA_A_Axis_Rotating_Stage_Fiberglass_pipes_mount_plate:1 ↔ DIN 934 - replaced by DIN EN 24032/28673/28674 M5:11
- Mate:159: 3DP_PLA_A_Axis_Rotating_Stage_Fiberglass_pipes_mount_clamp:2 ↔ DIN 934 - replaced by DIN EN 24032/28673/28674 M5:12
- Mate:160: 3DP_PLA_A_Axis_Rotating_Stage_Fiberglass_pipes_mount_plate:1 ↔ DIN 934 - replaced by DIN EN 24032/28673/28674 M5:12
- Mate:161: 3DP_PLA_A_Axis_Rotating_Stage_Fiberglass_pipes_mount_clamp:2 ↔ DIN 934 - replaced by DIN EN 24032/28673/28674 M5:13
- Mate:162: 3DP_PLA_A_Axis_Rotating_Stage_Fiberglass_pipes_mount_plate:1 ↔ DIN 934 - replaced by DIN EN 24032/28673/28674 M5:13
- Mate:163: 3DP_PLA_A_Axis_Rotating_Stage_Fiberglass_pipes_mount_clamp:2 ↔ DIN 934 - replaced by DIN EN 24032/28673/28674 M5:14
- Mate:164: 3DP_PLA_A_Axis_Rotating_Stage_Fiberglass_pipes_mount_plate:1 ↔ DIN 934 - replaced by DIN EN 24032/28673/28674 M5:14
- Mate:165: 3DP_PLA_A_Axis_Rotating_Stage_Fiberglass_pipes_mount_clamp:1 ↔ DIN 934 - replaced by DIN EN 24032/28673/28674 M5:15
- Mate:166: 3DP_PLA_A_Axis_Rotating_Stage_Fiberglass_pipes_mount_plate:1 ↔ DIN 934 - replaced by DIN EN 24032/28673/28674 M5:15
- Mate:167: 3DP_PLA_A_Axis_Rotating_Stage_Fiberglass_pipes_mount_clamp:1 ↔ DIN 934 - replaced by DIN EN 24032/28673/28674 M5:16
- Mate:168: 3DP_PLA_A_Axis_Rotating_Stage_Fiberglass_pipes_mount_plate:1 ↔ DIN 934 - replaced by DIN EN 24032/28673/28674 M5:16
- Mate:169: 3DP_PLA_A_Axis_Rotating_Stage_Fiberglass_pipes_mount_clamp:1 ↔ DIN 934 - replaced by DIN EN 24032/28673/28674 M5:17
- Mate:170: 3DP_PLA_A_Axis_Rotating_Stage_Fiberglass_pipes_mount_plate:1 ↔ DIN 934 - replaced by DIN EN 24032/28673/28674 M5:17
- Mate:171: 3DP_PLA_A_Axis_Rotating_Stage_Fiberglass_pipes_mount_clamp:1 ↔ DIN 934 - replaced by DIN EN 24032/28673/28674 M5:18
- Mate:172: 3DP_PLA_A_Axis_Rotating_Stage_Fiberglass_pipes_mount_plate:1 ↔ DIN 934 - replaced by DIN EN 24032/28673/28674 M5:18
- Mate:173: 3DP_PLA_A_Axis_Rotating_Stage_Fiberglass_pipes_mount_clamp:1 ↔ DIN 934 - replaced by DIN EN 24032/28673/28674 M5:19
- Mate:174: 3DP_PLA_A_Axis_Rotating_Stage_Fiberglass_pipes_mount_plate:1 ↔ DIN 934 - replaced by DIN EN 24032/28673/28674 M5:19
- Mate:175: 3DP_PLA_A_Axis_Rotating_Stage_Fiberglass_pipes_mount_clamp:1 ↔ DIN 934 - replaced by DIN EN 24032/28673/28674 M5:20
- Mate:176: 3DP_PLA_A_Axis_Rotating_Stage_Fiberglass_pipes_mount_plate:1 ↔ DIN 934 - replaced by DIN EN 24032/28673/28674 M5:20
- Angle:21 (0 deg): 3DP_PLA_A_Axis_Rotating_Stage_Fiberglass_pipes_mount_plate:1 ↔ DIN 934 - replaced by DIN EN 24032/28673/28674 M5:9
- Angle:22 (0 deg): 3DP_PLA_A_Axis_Rotating_Stage_Fiberglass_pipes_mount_plate:1 ↔ DIN 934 - replaced by DIN EN 24032/28673/28674 M5:12
- Angle:23 (0 deg): 3DP_PLA_A_Axis_Rotating_Stage_Fiberglass_pipes_mount_plate:1 ↔ DIN 934 - replaced by DIN EN 24032/28673/28674 M5:13
- Angle:24 (0 deg): 3DP_PLA_A_Axis_Rotating_Stage_Fiberglass_pipes_mount_plate:1 ↔ DIN 934 - replaced by DIN EN 24032/28673/28674 M5:14
- Angle:25 (0 deg): 3DP_PLA_A_Axis_Rotating_Stage_Fiberglass_pipes_mount_plate:1 ↔ DIN 934 - replaced by DIN EN 24032/28673/28674 M5:11
- Angle:26 (0 deg): 3DP_PLA_A_Axis_Rotating_Stage_Fiberglass_pipes_mount_plate:1 ↔ DIN 934 - replaced by DIN EN 24032/28673/28674 M5:10
- Angle:27 (0 deg): 3DP_PLA_A_Axis_Rotating_Stage_Fiberglass_pipes_mount_plate:1 ↔ DIN 934 - replaced by DIN EN 24032/28673/28674 M5:20
- Angle:28 (0 deg): 3DP_PLA_A_Axis_Rotating_Stage_Fiberglass_pipes_mount_plate:1 ↔ DIN 934 - replaced by DIN EN 24032/28673/28674 M5:19
- Angle:29 (0 deg): 3DP_PLA_A_Axis_Rotating_Stage_Fiberglass_pipes_mount_plate:1 ↔ DIN 934 - replaced by DIN EN 24032/28673/28674 M5:18
- Angle:30 (0 deg): 3DP_PLA_A_Axis_Rotating_Stage_Fiberglass_pipes_mount_plate:1 ↔ DIN 934 - replaced by DIN EN 24032/28673/28674 M5:17
- Angle:31 (0 deg): 3DP_PLA_A_Axis_Rotating_Stage_Fiberglass_pipes_mount_plate:1 ↔ DIN 934 - replaced by DIN EN 24032/28673/28674 M5:16
- Angle:32 (0 deg): 3DP_PLA_A_Axis_Rotating_Stage_Fiberglass_pipes_mount_plate:1 ↔ DIN 934 - replaced by DIN EN 24032/28673/28674 M5:15
- Mate:177: 3DP_PLA_A_Axis_Rotating_Stage_Fiberglass_pipes_mount_plate:1 ↔ DIN 912 - replaced by DIN EN ISO 4762 M4 x 20:1
- Mate:178: 3DP_PLA_A_Axis_Rotating_Stage_Fiberglass_pipes_mount_plate:1 ↔ DIN 912 - replaced by DIN EN ISO 4762 M4 x 20:1
- Mate:179: 3DP_PLA_A_Axis_Rotating_Stage_Fiberglass_pipes_mount_plate:1 ↔ DIN 912 - replaced by DIN EN ISO 4762 M4 x 20:2
- Mate:180: 3DP_PLA_A_Axis_Rotating_Stage_Fiberglass_pipes_mount_plate:1 ↔ DIN 912 - replaced by DIN EN ISO 4762 M4 x 20:2
- Mate:181: 3DP_PLA_A_Axis_Rotating_Stage_Fiberglass_pipes_mount_plate:1 ↔ DIN 912 - replaced by DIN EN ISO 4762 M4 x 20:3
- Mate:182: 3DP_PLA_A_Axis_Rotating_Stage_Fiberglass_pipes_mount_plate:1 ↔ DIN 912 - replaced by DIN EN ISO 4762 M4 x 20:3
- Mate:183: 3DP_PLA_A_Axis_Rotating_Stage_Fiberglass_pipes_mount_plate:1 ↔ DIN 912 - replaced by DIN EN ISO 4762 M4 x 20:4
- Mate:184: 3DP_PLA_A_Axis_Rotating_Stage_Fiberglass_pipes_mount_plate:1 ↔ DIN 912 - replaced by DIN EN ISO 4762 M4 x 20:4
- Mate:185: 3DP_PLA_A_Axis_Rotating_Stage_Fiberglass_pipes_mount_plate:1 ↔ DIN 912 - replaced by DIN EN ISO 4762 M4 x 20:5
- Mate:186: 3DP_PLA_A_Axis_Rotating_Stage_Fiberglass_pipes_mount_plate:1 ↔ DIN 912 - replaced by DIN EN ISO 4762 M4 x 20:5
- Mate:187: 3DP_PLA_A_Axis_Rotating_Stage_Fiberglass_pipes_mount_plate:1 ↔ DIN 912 - replaced by DIN EN ISO 4762 M4 x 20:6
- Mate:188: 3DP_PLA_A_Axis_Rotating_Stage_Fiberglass_pipes_mount_plate:1 ↔ DIN 912 - replaced by DIN EN ISO 4762 M4 x 20:6
- Mate:189: 3DP_PLA_A_Axis_Rotating_Stage_Fiberglass_pipes_mount_plate:1 ↔ DIN 912 - replaced by DIN EN ISO 4762 M4 x 20:7
- Mate:190: 3DP_PLA_A_Axis_Rotating_Stage_Fiberglass_pipes_mount_plate:1 ↔ DIN 912 - replaced by DIN EN ISO 4762 M4 x 20:7
- Mate:191: 3DP_PLA_A_Axis_Rotating_Stage_Fiberglass_pipes_mount_plate:1 ↔ DIN 912 - replaced by DIN EN ISO 4762 M4 x 20:8
- Mate:192: 3DP_PLA_A_Axis_Rotating_Stage_Fiberglass_pipes_mount_plate:1 ↔ DIN 912 - replaced by DIN EN ISO 4762 M4 x 20:8
- Mate:193: 3DP_PLA_A_Axis_Rotating_Stage_Fiberglass_pipes_mount_plate:1 ↔ DIN 934 - replaced by DIN EN 24032/28673/28674 M4:14
- Mate:194: 3DP_PLA_A_Axis_Rotating_Stage:1 ↔ DIN 934 - replaced by DIN EN 24032/28673/28674 M4:14
- Mate:195: 3DP_PLA_A_Axis_Rotating_Stage_Fiberglass_pipes_mount_plate:1 ↔ DIN 934 - replaced by DIN EN 24032/28673/28674 M4:15
- Mate:196: 3DP_PLA_A_Axis_Rotating_Stage:1 ↔ DIN 934 - replaced by DIN EN 24032/28673/28674 M4:15
- Mate:197: 3DP_PLA_A_Axis_Rotating_Stage_Fiberglass_pipes_mount_plate:1 ↔ DIN 934 - replaced by DIN EN 24032/28673/28674 M4:16
- Mate:198: 3DP_PLA_A_Axis_Rotating_Stage:1 ↔ DIN 934 - replaced by DIN EN 24032/28673/28674 M4:16
- Mate:199: 3DP_PLA_A_Axis_Rotating_Stage_Fiberglass_pipes_mount_plate:1 ↔ DIN 934 - replaced by DIN EN 24032/28673/28674 M4:17
- Mate:200: 3DP_PLA_A_Axis_Rotating_Stage:1 ↔ DIN 934 - replaced by DIN EN 24032/28673/28674 M4:17
- Mate:201: 3DP_PLA_A_Axis_Rotating_Stage_Fiberglass_pipes_mount_plate:1 ↔ DIN 934 - replaced by DIN EN 24032/28673/28674 M4:18
- Mate:202: 3DP_PLA_A_Axis_Rotating_Stage:1 ↔ DIN 934 - replaced by DIN EN 24032/28673/28674 M4:18
- Mate:203: 3DP_PLA_A_Axis_Rotating_Stage_Fiberglass_pipes_mount_plate:1 ↔ DIN 934 - replaced by DIN EN 24032/28673/28674 M4:19
- Mate:204: 3DP_PLA_A_Axis_Rotating_Stage:1 ↔ DIN 934 - replaced by DIN EN 24032/28673/28674 M4:19
- Mate:205: 3DP_PLA_A_Axis_Rotating_Stage_Fiberglass_pipes_mount_plate:1 ↔ DIN 934 - replaced by DIN EN 24032/28673/28674 M4:20
- Mate:206: 3DP_PLA_A_Axis_Rotating_Stage:1 ↔ DIN 934 - replaced by DIN EN 24032/28673/28674 M4:20
- Mate:207: 3DP_PLA_A_Axis_Rotating_Stage_Fiberglass_pipes_mount_plate:1 ↔ DIN 934 - replaced by DIN EN 24032/28673/28674 M4:21
- Mate:208: 3DP_PLA_A_Axis_Rotating_Stage:1 ↔ DIN 934 - replaced by DIN EN 24032/28673/28674 M4:21
- Angle:33 (0 deg): 3DP_PLA_A_Axis_Rotating_Stage:1 ↔ DIN 934 - replaced by DIN EN 24032/28673/28674 M4:17
- Angle:34 (0 deg): 3DP_PLA_A_Axis_Rotating_Stage:1 ↔ DIN 934 - replaced by DIN EN 24032/28673/28674 M4:15
- Angle:35 (0 deg): 3DP_PLA_A_Axis_Rotating_Stage:1 ↔ DIN 934 - replaced by DIN EN 24032/28673/28674 M4:14
- Angle:36 (0 deg): 3DP_PLA_A_Axis_Rotating_Stage:1 ↔ DIN 934 - replaced by DIN EN 24032/28673/28674 M4:16
- Angle:37 (0 deg): 3DP_PLA_A_Axis_Rotating_Stage:1 ↔ DIN 934 - replaced by DIN EN 24032/28673/28674 M4:21
- Angle:38 (0 deg): 3DP_PLA_A_Axis_Rotating_Stage:1 ↔ DIN 934 - replaced by DIN EN 24032/28673/28674 M4:20
- Angle:39 (0 deg): 3DP_PLA_A_Axis_Rotating_Stage:1 ↔ DIN 934 - replaced by DIN EN 24032/28673/28674 M4:19
- Angle:40 (0 deg): 3DP_PLA_A_Axis_Rotating_Stage:1 ↔ DIN 934 - replaced by DIN EN 24032/28673/28674 M4:18
- Angle:41 (0 deg): 3DP_PLA_A_Axis_Rotating_Stage_Fiberglass_pipes_mount_plate:1
- Mate:250: COTS_CARBONCENTER_Fiberglass_Tube_27x24x383mm:6 ↔ 3DP_PLA_Fiberglass_Pipe_Corner_Bracket:2
- Mate:251: COTS_CARBONCENTER_Fiberglass_Tube_27x24x383mm:5 ↔ 3DP_PLA_Fiberglass_Pipe_Corner_Bracket:2
- Mate:252: COTS_CARBONCENTER_Fiberglass_Tube_27x24x383mm:8 ↔ 3DP_PLA_Fiberglass_Pipe_Corner_Bracket:2
- Mate:253: COTS_CARBONCENTER_Fiberglass_Tube_27x24x383mm:7 ↔ 3DP_PLA_Fiberglass_Pipe_Corner_Bracket:2
- Mate:254: COTS_CARBONCENTER_Fiberglass_Tube_27x24x383mm:5 ↔ 3DP_PLA_Fiberglass_Pipe_Corner_Bracket_Clamp:2
- Mate:255: COTS_CARBONCENTER_Fiberglass_Tube_27x24x383mm:6 ↔ 3DP_PLA_Fiberglass_Pipe_Corner_Bracket_Clamp:2
- Mate:256: COTS_CARBONCENTER_Fiberglass_Tube_27x24x383mm:7 ↔ 3DP_PLA_Fiberglass_Pipe_Corner_Bracket_Clamp:3
- Mate:257: COTS_CARBONCENTER_Fiberglass_Tube_27x24x383mm:8 ↔ 3DP_PLA_Fiberglass_Pipe_Corner_Bracket_Clamp:3
- Flush:9: 3DP_PLA_Fiberglass_Pipe_Corner_Bracket:2 ↔ 3DP_PLA_Fiberglass_Pipe_Corner_Bracket_Clamp:3
- Flush:10: 3DP_PLA_Fiberglass_Pipe_Corner_Bracket:2 ↔ 3DP_PLA_Fiberglass_Pipe_Corner_Bracket_Clamp:2
- Flush:11: COTS_CARBONCENTER_Fiberglass_Tube_27x24x383mm:5 ↔ 3DP_PLA_Fiberglass_Pipe_Corner_Bracket_Clamp:2
- Flush:12: COTS_CARBONCENTER_Fiberglass_Tube_27x24x383mm:6 ↔ 3DP_PLA_Fiberglass_Pipe_Corner_Bracket_Clamp:2
- Flush:13: COTS_CARBONCENTER_Fiberglass_Tube_27x24x383mm:7 ↔ 3DP_PLA_Fiberglass_Pipe_Corner_Bracket_Clamp:3
- Flush:14: COTS_CARBONCENTER_Fiberglass_Tube_27x24x383mm:8 ↔ 3DP_PLA_Fiberglass_Pipe_Corner_Bracket_Clamp:3
- Mate:282: 3DP_PLA_Fiberglass_Pipe_Corner_Bracket_Clamp:2 ↔ COTS_DREMEC_8G206M6X50_M6x50_Nylon_Screw:13
- Mate:283: 3DP_PLA_Fiberglass_Pipe_Corner_Bracket_Clamp:2 ↔ COTS_DREMEC_8G206M6X50_M6x50_Nylon_Screw:16
- Mate:284: 3DP_PLA_Fiberglass_Pipe_Corner_Bracket_Clamp:2 ↔ COTS_DREMEC_8G206M6X50_M6x50_Nylon_Screw:15
- Mate:285: 3DP_PLA_Fiberglass_Pipe_Corner_Bracket_Clamp:2 ↔ COTS_DREMEC_8G206M6X50_M6x50_Nylon_Screw:14
- Mate:286: 3DP_PLA_Fiberglass_Pipe_Corner_Bracket_Clamp:2 ↔ COTS_DREMEC_8G206M6X50_M6x50_Nylon_Screw:17
- Mate:287: 3DP_PLA_Fiberglass_Pipe_Corner_Bracket_Clamp:2 ↔ COTS_DREMEC_8G206M6X50_M6x50_Nylon_Screw:18
- Mate:288: 3DP_PLA_Fiberglass_Pipe_Corner_Bracket_Clamp:3 ↔ COTS_DREMEC_8G206M6X50_M6x50_Nylon_Screw:19
- Mate:289: 3DP_PLA_Fiberglass_Pipe_Corner_Bracket_Clamp:3 ↔ COTS_DREMEC_8G206M6X50_M6x50_Nylon_Screw:20
- Mate:290: 3DP_PLA_Fiberglass_Pipe_Corner_Bracket_Clamp:3 ↔ COTS_DREMEC_8G206M6X50_M6x50_Nylon_Screw:22
- Mate:291: 3DP_PLA_Fiberglass_Pipe_Corner_Bracket_Clamp:3 ↔ COTS_DREMEC_8G206M6X50_M6x50_Nylon_Screw:21
- Mate:292: 3DP_PLA_Fiberglass_Pipe_Corner_Bracket_Clamp:3 ↔ COTS_DREMEC_8G206M6X50_M6x50_Nylon_Screw:23
- Mate:293: 3DP_PLA_Fiberglass_Pipe_Corner_Bracket_Clamp:3 ↔ COTS_DREMEC_8G206M6X50_M6x50_Nylon_Screw:24
- Mate:294: 3DP_PLA_Fiberglass_Pipe_Corner_Bracket_Clamp:3 ↔ COTS_DREMEC_8G206M6X50_M6x50_Nylon_Screw:22
- Mate:295: 3DP_PLA_Fiberglass_Pipe_Corner_Bracket_Clamp:3 ↔ COTS_DREMEC_8G206M6X50_M6x50_Nylon_Screw:20
- Mate:296: 3DP_PLA_Fiberglass_Pipe_Corner_Bracket_Clamp:3 ↔ COTS_DREMEC_8G206M6X50_M6x50_Nylon_Screw:19
- Mate:297: 3DP_PLA_Fiberglass_Pipe_Corner_Bracket_Clamp:3 ↔ COTS_DREMEC_8G206M6X50_M6x50_Nylon_Screw:23
- Mate:298: 3DP_PLA_Fiberglass_Pipe_Corner_Bracket_Clamp:3 ↔ COTS_DREMEC_8G206M6X50_M6x50_Nylon_Screw:21